# Autodesk Inventor assembly: 4861 RP-696x1246x44
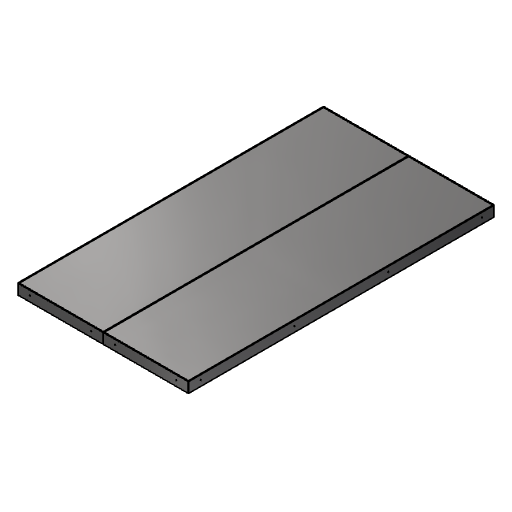
[picture p0: Inventor's stored thumbnail of the model, 512x512]
Saved by Autodesk Inventor 2024.3 (Build 283343000, 343)
## iProperties
RuleStatus: InUse
Created: 2019-06-24
Part Number: 4861 RP-696x1246x44
Material: Generisch
Document SubType Name: Assembly
Designer: MK
Mass: 17115.3 g
Surface Area: 43497.8 cm^2
Volume: 2231.04 cm^3
Density: 7.67146 g/cm^3
Description: Tür-Paneel
InventorSizerSetup: RP 1
Author: MK
## Documents named in this file (4)
- C:\Users\la\Documents\GitHub\Inventor_Sizer\C# Version\GR\Einzelteile\4861 RP-696x1246x44.iam
- C:\Users\la\Documents\GitHub\Inventor_Sizer\C# Version\GR\Einzelteile\4861 696x1246x44-Au.ipt
- C:\Users\la\Documents\GitHub\Inventor_Sizer\C# Version\GR\Einzelteile\4861 696x1246x44-In-2T.ipt
- C:\Users\la\Documents\GitHub\Inventor_Sizer\C# Version\masters\RP\1T\MFG1000000.ipt
## Components (5 placed, 3 different names)
1. 4861 696x1246x44-Au:1 — Mate:6, Mate:7, Mate:8, Mate:12, Mate:13, Mate:14
2. 4861 696x1246x44-In-2T:1 — Mate:6, Mate:7, Mate:8
3. 4861 696x1246x44-In-2T:2
4. MFG1000000:1 — Mate:12, Mate:13, Mate:14
5. MFG1000000:2
## Component patterns: (2 elements, first: 4861 696x1246x44-In-2T:1), (2 elements, first: MFG1000000:1)
## Relationships (6: Mate 6)
- Mate:6: 4861 696x1246x44-Au:1 ↔ 4861 696x1246x44-In-2T:1
- Mate:7 (0.5 mm): 4861 696x1246x44-Au:1 ↔ 4861 696x1246x44-In-2T:1
- Mate:8 (0.5 mm): 4861 696x1246x44-Au:1 ↔ 4861 696x1246x44-In-2T:1
- Mate:12: 4861 696x1246x44-Au:1 ↔ MFG1000000:1
- Mate:13: 4861 696x1246x44-Au:1 ↔ MFG1000000:1
- Mate:14: 4861 696x1246x44-Au:1 ↔ MFG1000000:1
## Named parameters: Clearance = 0.5 mm, Width = 696 mm, InSplit = 2, InWidth = 346.5 mm, HandleCount = 2, HandleDir = 0, HandlePitch = 623 mm, HandleRef = 1246 mm, Length = 1246 mm, HandlePitchW = 0 mm, HandlePitchL = 623 mm, HandleCountL = 2, HandleCountW = 1
